# Autodesk Inventor assembly: Planning_Hull_Section
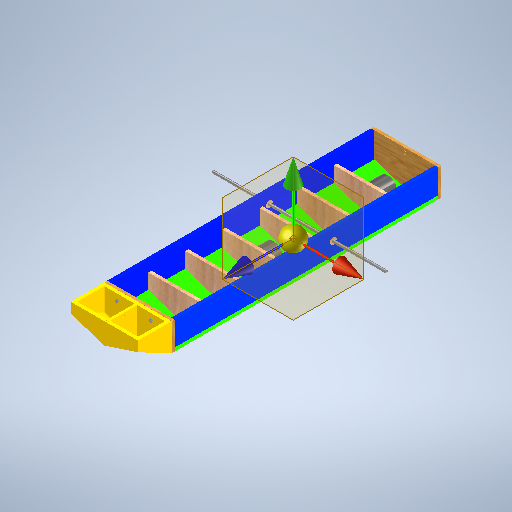
[picture p0: Inventor's stored thumbnail of the model, 512x512]
Saved by Autodesk Inventor 2026.2 (Build 302298000, 298)
## iProperties
Created: 2026-07-14
Part Number: Planning_Hull_Section
Document SubType Name: Assembly
Designer: Taiye Raji
Mass: 27157.6 g
Surface Area: 42813.2 cm^2
Volume: 36840.3 cm^3
Density: 0.737172 g/cm^3
Author: Taiye Raji
## Documents named in this file (15)
- C:\Users\Taiye Raji\OneDrive - Stellenbosch University\Desktop\STELLENBOSCH UNIVERSITY MODULES\FOURTH YEAR MODULES\MECHATRONIC PROJECT\DRAWINGS\Planning_Hull_Section.iam
- C:\Users\Taiye Raji\OneDrive - Stellenbosch University\Desktop\STELLENBOSCH UNIVERSITY MODULES\FOURTH YEAR MODULES\MECHATRONIC PROJECT\DRAWINGS\Bow_Tansform_Plate.ipt
- C:\Users\Taiye Raji\OneDrive - Stellenbosch University\Desktop\STELLENBOSCH UNIVERSITY MODULES\FOURTH YEAR MODULES\MECHATRONIC PROJECT\DRAWINGS\Higher_Section_Plate.ipt
- C:\Users\Taiye Raji\OneDrive - Stellenbosch University\Desktop\STELLENBOSCH UNIVERSITY MODULES\FOURTH YEAR MODULES\MECHATRONIC PROJECT\DRAWINGS\Higher_Section_Plate2.ipt
- C:\Users\Taiye Raji\OneDrive - Stellenbosch University\Desktop\STELLENBOSCH UNIVERSITY MODULES\FOURTH YEAR MODULES\MECHATRONIC PROJECT\DRAWINGS\Low_Section_Plate.ipt
- C:\Users\Taiye Raji\OneDrive - Stellenbosch University\Desktop\STELLENBOSCH UNIVERSITY MODULES\FOURTH YEAR MODULES\MECHATRONIC PROJECT\DRAWINGS\Bow_Tansform_Plate_No_Holes.ipt
- C:\Users\Taiye Raji\OneDrive - Stellenbosch University\Desktop\STELLENBOSCH UNIVERSITY MODULES\FOURTH YEAR MODULES\MECHATRONIC PROJECT\DRAWINGS\Low_Section_Plate_MIR2.ipt
- C:\Users\Taiye Raji\OneDrive - Stellenbosch University\Desktop\STELLENBOSCH UNIVERSITY MODULES\FOURTH YEAR MODULES\MECHATRONIC PROJECT\DRAWINGS\CIRCULAR WOODEN BOARD.ipt
- C:\Users\Taiye Raji\OneDrive - Stellenbosch University\Desktop\STELLENBOSCH UNIVERSITY MODULES\FOURTH YEAR MODULES\MECHATRONIC PROJECT\DRAWINGS\Steel Rod.ipt
- C:\Users\Taiye Raji\OneDrive - Stellenbosch University\Desktop\STELLENBOSCH UNIVERSITY MODULES\FOURTH YEAR MODULES\MECHATRONIC PROJECT\DRAWINGS\WOODEN RIB.ipt
- C:\Users\Taiye Raji\OneDrive - Stellenbosch University\Desktop\STELLENBOSCH UNIVERSITY MODULES\FOURTH YEAR MODULES\MECHATRONIC PROJECT\DRAWINGS\Ballast Weights.ipt
- C:\Users\Taiye Raji\OneDrive - Stellenbosch University\Documents\Inventor\Content Center Files\R2026\en-US\ISO 2341 A(1)\ISO 2341 - A - 3 x 18ISO.ipt
- C:\Users\Taiye Raji\OneDrive - Stellenbosch University\Desktop\STELLENBOSCH UNIVERSITY MODULES\FOURTH YEAR MODULES\MECHATRONIC PROJECT\DRAWINGS\BOW ASSEMBLY.iam
- C:\Users\Taiye Raji\OneDrive - Stellenbosch University\Documents\Inventor\Content Center Files\R2026\en-US\ISO 4017(1)\ISO 4017 - M10 x 45 - ISO.ipt
- C:\Users\Taiye Raji\OneDrive - Stellenbosch University\Documents\Inventor\Content Center Files\R2026\en-US\ISO 4032(2)\ISO 4032 - M10 - ISO.ipt
## Components (29 placed, 14 different names)
1. Bow_Tansform_Plate:1 — Mate:2, Flush:1, Mate:33, Flush:29, Flush:30, Flush:36, Flush:37, Mate:44, Angle:1, Angle:2, Flush:40, Mate:53, Flush:41, Flush:42, Mate:54, Flush:43, Flush:44, Mate:59, Mate:62, Flush:50, Flush:51, Insert:1, Insert:2, Insert:3, Insert:4
2. Higher_Section_Plate:1 — Mate:53, Flush:41, Flush:42, Flush:46
3. Higher_Section_Plate2:1 — Mate:54, Flush:43, Flush:44, Mate:55, Mate:56, Flush:45, Flush:47, Mate:58, Flush:48
4. Low_Section_Plate:1 — Mate:33, Flush:29, Flush:30, Mate:46, Flush:49, Tangent:2, Tangent:3
5. Low_Section_Plate_MIR2:1 — Flush:36, Flush:37, Mate:44, Tangent:1, Tangent:4
6. CIRCULAR WOODEN BOARD:1 — Mate:57, Flush:46
7. CIRCULAR WOODEN BOARD:2 — Mate:38, Mate:56, Flush:45
8. Steel Rod:1 — Mate:38, Mate:57, Flush:47, Mate:60, Tangent:5, Mate:61, Tangent:6
9. Bow_Tansform_Plate_No_Holes:2 — Mate:58, Flush:48, Flush:49
10. Ballast Weights:1 — Tangent:1, Tangent:2
11. Ballast Weights:2 — Tangent:3, Tangent:4
12. ISO 2341 A A - 3 x 18:1 — Mate:60, Tangent:5
13. ISO 2341 A A - 3 x 18:2 — Mate:61, Tangent:6
14. BOW ASSEMBLY:1 [sub-assembly] — Mate:62, Flush:50, Flush:51, Mate:64, Mate:66, Mate:68, Mate:70
15. ISO 4017 M10 x 45:1 — Insert:1, Mate:65
16. ISO 4017 M10 x 45:2 — Insert:2, Mate:69
17. ISO 4017 M10 x 45:3 — Insert:3, Mate:67
18. ISO 4017 M10 x 45:4 — Insert:4, Mate:63
19. ISO 4032 M10:1 — Mate:63, Mate:64
20. ISO 4032 M10:2 — Mate:65, Mate:66
21. ISO 4032 M10:3 — Mate:67, Mate:68
22. ISO 4032 M10:4 — Mate:69, Mate:70
23. WOODEN RIB:1 — Angle:1, Angle:2, Mate:46, Mate:55, Mate:59
24. WOODEN RIB:2
25. WOODEN RIB:3
26. WOODEN RIB:4
27. WOODEN RIB:5
28. WOODEN RIB:6
29. WOODEN RIB:7
## Component patterns: (8 elements, first: WOODEN RIB:1)
## Relationships (52: Mate 23, Flush 17, Tangent 6, Insert 4, Angle 2)
- Mate:2: Bow_Tansform_Plate:1
- Flush:1: Bow_Tansform_Plate:1
- Mate:33: Bow_Tansform_Plate:1 ↔ Low_Section_Plate:1
- Mate:38: CIRCULAR WOODEN BOARD:2 ↔ Steel Rod:1
- Flush:29: Bow_Tansform_Plate:1 ↔ Low_Section_Plate:1
- Flush:30: Bow_Tansform_Plate:1 ↔ Low_Section_Plate:1
- Flush:36: Bow_Tansform_Plate:1 ↔ Low_Section_Plate_MIR2:1
- Flush:37: Bow_Tansform_Plate:1 ↔ Low_Section_Plate_MIR2:1
- Mate:44: Bow_Tansform_Plate:1 ↔ Low_Section_Plate_MIR2:1
- Angle:1 (0 deg): Bow_Tansform_Plate:1 ↔ WOODEN RIB:1
- Angle:2 (0 deg): Bow_Tansform_Plate:1 ↔ WOODEN RIB:1
- Mate:46: Low_Section_Plate:1 ↔ WOODEN RIB:1
- Flush:40 (1600 mm): Bow_Tansform_Plate:1
- Mate:53: Bow_Tansform_Plate:1 ↔ Higher_Section_Plate:1
- Flush:41: Bow_Tansform_Plate:1 ↔ Higher_Section_Plate:1
- Flush:42: Bow_Tansform_Plate:1 ↔ Higher_Section_Plate:1
- Mate:54: Bow_Tansform_Plate:1 ↔ Higher_Section_Plate2:1
- Flush:43: Bow_Tansform_Plate:1 ↔ Higher_Section_Plate2:1
- Flush:44: Bow_Tansform_Plate:1 ↔ Higher_Section_Plate2:1
- Mate:55: Higher_Section_Plate2:1 ↔ WOODEN RIB:1
- Mate:56: Higher_Section_Plate2:1 ↔ CIRCULAR WOODEN BOARD:2
- Flush:45: Higher_Section_Plate2:1 ↔ CIRCULAR WOODEN BOARD:2
- Mate:57: CIRCULAR WOODEN BOARD:1 ↔ Steel Rod:1
- Flush:46: Higher_Section_Plate:1 ↔ CIRCULAR WOODEN BOARD:1
- Flush:47 (-315 mm): Higher_Section_Plate2:1 ↔ Steel Rod:1
- Mate:58: Higher_Section_Plate2:1 ↔ Bow_Tansform_Plate_No_Holes:2
- Flush:48: Higher_Section_Plate2:1 ↔ Bow_Tansform_Plate_No_Holes:2
- Flush:49: Low_Section_Plate:1 ↔ Bow_Tansform_Plate_No_Holes:2
- Tangent:1: Low_Section_Plate_MIR2:1 ↔ Ballast Weights:1
- Tangent:2: Low_Section_Plate:1 ↔ Ballast Weights:1
- Tangent:3: Low_Section_Plate:1 ↔ Ballast Weights:2
- Tangent:4: Low_Section_Plate_MIR2:1 ↔ Ballast Weights:2
- Mate:59: Bow_Tansform_Plate:1 ↔ WOODEN RIB:1
- Mate:60: Steel Rod:1 ↔ ISO 2341 A A - 3 x 18:1
- Tangent:5: Steel Rod:1 ↔ ISO 2341 A A - 3 x 18:1
- Mate:61: Steel Rod:1 ↔ ISO 2341 A A - 3 x 18:2
- Tangent:6: Steel Rod:1 ↔ ISO 2341 A A - 3 x 18:2
- Mate:62: Bow_Tansform_Plate:1 ↔ BOW ASSEMBLY:1
- Flush:50: Bow_Tansform_Plate:1 ↔ BOW ASSEMBLY:1
- Flush:51: Bow_Tansform_Plate:1 ↔ BOW ASSEMBLY:1
- Insert:1: Bow_Tansform_Plate:1 ↔ ISO 4017 M10 x 45:1
- Insert:2: Bow_Tansform_Plate:1 ↔ ISO 4017 M10 x 45:2
- Insert:3: Bow_Tansform_Plate:1 ↔ ISO 4017 M10 x 45:3
- Insert:4: Bow_Tansform_Plate:1 ↔ ISO 4017 M10 x 45:4
- Mate:63: ISO 4017 M10 x 45:4 ↔ ISO 4032 M10:1
- Mate:64: BOW ASSEMBLY:1 ↔ ISO 4032 M10:1
- Mate:65: ISO 4017 M10 x 45:1 ↔ ISO 4032 M10:2
- Mate:66: BOW ASSEMBLY:1 ↔ ISO 4032 M10:2
- Mate:67: ISO 4017 M10 x 45:3 ↔ ISO 4032 M10:3
- Mate:68: BOW ASSEMBLY:1 ↔ ISO 4032 M10:3
- Mate:69: ISO 4017 M10 x 45:2 ↔ ISO 4032 M10:4
- Mate:70: BOW ASSEMBLY:1 ↔ ISO 4032 M10:4
